# Autodesk Inventor assembly: MM0948AN180_G11_001
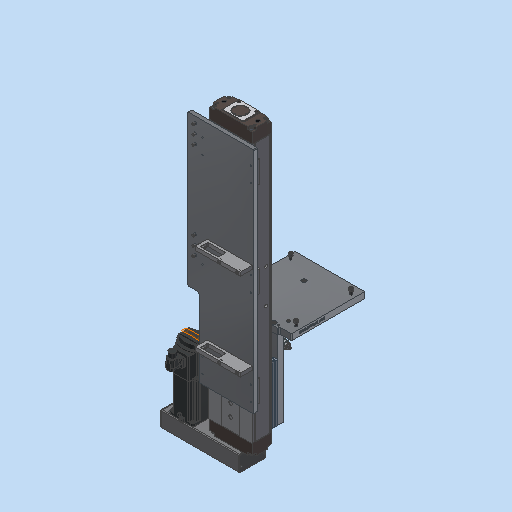
[picture p0: Inventor's stored thumbnail of the model, 512x512]
Saved by Autodesk Inventor 2023.3 (Build 273359000, 359)
## iProperties
Part Number: MM0948AN180_G11_001
Material: Generisch
Description: =<RBPARTNOTITLE2>
Document SubType Name: Assembly
Designer: FH/Wi
Mass: 75638.9 g
Surface Area: 20071.3 cm^2
Volume: 12011.2 cm^3
Density: 6.29734 g/cm^3
Created: 2023-03-23
RBPARTMADEOF: --
RBDRAWINGMISSINGSPEC: --
AnP_Kategorie: 99
RBPARTNOTITLE2: Magazinachse CIPG
RBSURFACE: --
RBPARTNOTITLE1: depot axis CIPG
AnP_Material: =<Material>
RBMATERIAL: =<Material>
RBMATNO: =<Part Number>
RBPARTNO: SIEHE MNR
Author: FH/Wi
Keywords: =<RBPARTMADEOF>
Comments: =<RBSURFACE2>
Revision Number: 01
## Documents named in this file (27)
- C:\Users\rea9an\Documents\Inventor\TCAI2412_te1910_EM\AS00000970.iam
- C:\Users\rea9an\Documents\Inventor\TCAI2412_te1910_EM\PT00004895.ipt
- C:\Users\rea9an\Documents\Inventor\TCAI2412_te1910_EM\PT00004901.ipt
- C:\Users\rea9an\Documents\Inventor\TCAI2412_te1910_EM\AS00000904.iam
- C:\Users\rea9an\Documents\Inventor\TCAI2412_te1910_EM\PT00004791.ipt
- C:\Users\rea9an\Documents\Inventor\TCAI2412_te1910_EM\PT00004523.ipt
- C:\Users\rea9an\Documents\Inventor\TCAI2412_te1910_EM\PT00004887.ipt
- C:\Users\rea9an\Documents\Inventor\TCAI2412_te1910_EM\PT00004891.ipt
- C:\Users\rea9an\Documents\Inventor\TCAI2412_te1910_EM\PT00004519.ipt
- C:\Users\rea9an\Documents\Inventor\TCAI2412_te1910_EM\PT00004518.ipt
- C:\Users\rea9an\Documents\Inventor\TCAI2412_te1910_EM\PT00004517.ipt
- C:\Users\rea9an\Documents\Inventor\TCAI2412_te1910_EM\PT00004520.ipt
- C:\Users\rea9an\Documents\Inventor\TCAI2412_te1910_EM\PT00004521.ipt
- C:\Users\rea9an\Documents\Inventor\TCAI2412_te1910_EM\PT00004292.ipt
- C:\Users\rea9an\Documents\Inventor\TCAI2412_te1910_EM\PT00004888.ipt
- C:\Users\rea9an\Documents\Inventor\TCAI2412_te1910_EM\PT00004886.ipt
- C:\Users\rea9an\Documents\Inventor\TCAI2412_te1910_EM\PT00004903.ipt
- C:\Users\rea9an\Documents\Inventor\TCAI2412_te1910_EM\PT00004896.ipt
- C:\Users\rea9an\Documents\Inventor\TCAI2412_te1910_EM\PT00004902.ipt
- C:\Users\rea9an\Documents\Inventor\TCAI2412_te1910_EM\PT00004711.ipt
- C:\Users\rea9an\Documents\Inventor\TCAI2412_te1910_EM\PT00004712.ipt
- C:\Users\rea9an\Documents\Inventor\TCAI2412_te1910_EM\PT00004713.ipt
- C:\Users\rea9an\Documents\Inventor\TCAI2412_te1910_EM\PT00004714.ipt
- C:\Users\rea9an\Documents\Inventor\TCAI2412_te1910_EM\PT00004897.ipt
- C:\Users\rea9an\Documents\Inventor\TCAI2412_te1910_EM\PT00004909.ipt
- C:\Users\rea9an\Documents\Inventor\TCAI2412_te1910_EM\PT00004877.ipt
- C:\Users\rea9an\Documents\Inventor\TCAI2412_te1910_EM\PT00004715.ipt
## Components (75 placed, 26 different names)
1. PT00004711:1 — Einfügen:3, Einfügen:5
2. PT00004715:1 — Einfügen:5, Passend:10, Einfügen:6, Einfügen:7, Einfügen:8, Einfügen:9, Einfügen:10, Einfügen:72, Einfügen:73, Einfügen:74, Einfügen:75, Einfügen:76, Einfügen:77, Einfügen:78, Einfügen:79
3. PT00004712:1 — Einfügen:3, Passend:10, Einfügen:34, Einfügen:36, Einfügen:37, Einfügen:38, Einfügen:39, Einfügen:40, Einfügen:41, Einfügen:42, Einfügen:43, Einfügen:44, Einfügen:45, Einfügen:46, Einfügen:67, Einfügen:68, Einfügen:69, Einfügen:70, Einfügen:71, Hub
4. PT00004713:1 — Passend:23, Passend:24, Passend:26, Passend:27, Passend:28, Passend:29, Passend:30, Einfügen:18, Einfügen:19, Passend:35, Passend:36, Fluchtend:24, Passend:37, Passend:39, Passend:40, Einfügen:59, Einfügen:60, Einfügen:61, Einfügen:62, Einfügen:63, Einfügen:64, Passend:50, Passend:51, Passend:52
5. PT00004714:1 — Passend:35, Einfügen:21, Passend:39, Passend:40, Einfügen:22, Einfügen:23
6. PT00004714:2 — Passend:36, Fluchtend:24, Einfügen:20, Passend:37, Einfügen:24, Einfügen:25
7. PT00004877:1 — Einfügen:78
8. PT00004877:2 — Einfügen:79
9. PT00004909:1 — Einfügen:76
10. PT00004909:2 — Einfügen:77
11. PT00004897:1 — Einfügen:73
12. PT00004897:2 — Einfügen:72
13. PT00004897:3 — Einfügen:75
14. PT00004897:4 — Einfügen:74
15. PT00004519:1
16. PT00004518:1 — Passend:53
17. PT00004517:1 — Einfügen:33
18. PT00004520:1
19. PT00004521:1 — Einfügen:34, Winkel:3, Passend:53
20. PT00004887:1 — Einfügen:20
21. PT00004887:2 — Einfügen:21
22. PT00004891:1 — Einfügen:25
23. PT00004891:2 — Einfügen:24
24. PT00004891:3 — Einfügen:23
25. PT00004891:4 — Einfügen:22
26. PT00004791:1 — Einfügen:66
27. PT00004791:2 — Einfügen:65
28. PT00004791:3 — Einfügen:19, Passend:48
29. PT00004791:4 — Einfügen:18, Passend:31
30. PT00004895:1 — Einfügen:6
31. PT00004895:2 — Einfügen:7
32. PT00004895:3 — Einfügen:8
33. PT00004901:1 — Einfügen:9
34. PT00004901:2 — Einfügen:10
35. AS00000904:1 [sub-assembly] — Passend:23, Passend:31, Einfügen:33, Winkel:3, Passend:48, Einfügen:65, Einfügen:66, Einfügen:67, Hub
36. PT00004888:1
37. PT00004292:1 — Einfügen:36
38. PT00004292:2 — Einfügen:37
39. PT00004292:3 — Einfügen:38
40. PT00004292:4 — Einfügen:41
41. PT00004292:5 — Einfügen:40
42. PT00004292:6 — Einfügen:39
43. PT00004888:2 — Einfügen:42
44. PT00004888:3 — Einfügen:43
45. PT00004888:4 — Einfügen:44
46. PT00004888:5 — Einfügen:45
47. PT00004888:6 — Einfügen:46
48. PT00004886:1 — Einfügen:48
49. PT00004886:2 — Einfügen:47
50. PT00004886:3 — Einfügen:49
51. PT00004886:4 — Einfügen:50
52. PT00004886:5 — Einfügen:51
53. PT00004886:6 — Einfügen:52
54. PT00004886:7 — Einfügen:53
55. PT00004886:8 — Einfügen:54
56. PT00004886:9 — Einfügen:55
57. PT00004886:10 — Einfügen:56
58. PT00004886:11 — Einfügen:57
59. PT00004886:12 — Einfügen:58
60. PT00004895:4 — Einfügen:59
61. PT00004895:5 — Einfügen:60
62. PT00004895:6 — Einfügen:61
63. PT00004895:7 — Einfügen:62
64. PT00004903:1 — Einfügen:63
65. PT00004903:2 — Einfügen:64
66. PT00004896:1 — Einfügen:71
67. PT00004902:1 — Einfügen:68
68. PT00004896:2 — Einfügen:70
69. PT00004902:2 — Einfügen:69
70. PT00004523:2 — Passend:26, Passend:27, Passend:28, Einfügen:51, Einfügen:52
71. PT00004523:1 — Passend:24, Passend:29, Passend:30, Einfügen:53, Einfügen:54
72. PT00004523:3 — Einfügen:49, Einfügen:50
73. PT00004523:4 — Einfügen:55, Einfügen:56
74. PT00004523:5 — Einfügen:47, Einfügen:48
75. PT00004523:6 — Einfügen:57, Einfügen:58
## Component patterns: (3 elements, first: PT00004523:2 + PT00004523:1)
## Relationships (91: Insert 63, Mate 24, Flush 2, Angle 2)
- Einfügen:3 [Insert]: PT00004711:1 ↔ PT00004712:1
- Einfügen:5 [Insert]: PT00004711:1 ↔ PT00004715:1
- Passend:10 [Mate]: PT00004715:1 ↔ PT00004712:1
- Einfügen:6 [Insert]: PT00004715:1 ↔ PT00004895:1
- Einfügen:7 [Insert]: PT00004715:1 ↔ PT00004895:2
- Einfügen:8 [Insert]: PT00004715:1 ↔ PT00004895:3
- Einfügen:9 [Insert]: PT00004715:1 ↔ PT00004901:1
- Einfügen:10 [Insert]: PT00004715:1 ↔ PT00004901:2
- Passend:23 [Mate]: PT00004713:1 ↔ AS00000904:1
- Passend:24 [Mate]: PT00004713:1 ↔ PT00004523:1
- Passend:26 [Mate]: PT00004713:1 ↔ PT00004523:2
- Passend:27 [Mate]: PT00004713:1 ↔ PT00004523:2
- Passend:28 [Mate]: PT00004713:1 ↔ PT00004523:2
- Passend:29 [Mate]: PT00004713:1 ↔ PT00004523:1
- Passend:30 [Mate]: PT00004713:1 ↔ PT00004523:1
- Einfügen:18 [Insert]: PT00004713:1 ↔ PT00004791:4
- Einfügen:19 [Insert]: PT00004713:1 ↔ PT00004791:3
- Passend:31 [Mate]: PT00004791:4 ↔ AS00000904:1
- Passend:35 [Mate]: PT00004713:1 ↔ PT00004714:1
- Passend:36 [Mate]: PT00004713:1 ↔ PT00004714:2
- Fluchtend:24 [Flush] (65 mm): PT00004713:1 ↔ PT00004714:2
- Einfügen:20 [Insert]: PT00004714:2 ↔ PT00004887:1
- Einfügen:21 [Insert]: PT00004714:1 ↔ PT00004887:2
- Passend:37 [Mate]: PT00004713:1 ↔ PT00004714:2
- Passend:39 [Mate]: PT00004713:1 ↔ PT00004714:1
- Passend:40 [Mate]: PT00004713:1 ↔ PT00004714:1
- Einfügen:22 [Insert]: PT00004714:1 ↔ PT00004891:4
- Einfügen:23 [Insert]: PT00004714:1 ↔ PT00004891:3
- Einfügen:24 [Insert]: PT00004714:2 ↔ PT00004891:2
- Einfügen:25 [Insert]: PT00004714:2 ↔ PT00004891:1
- [Insert]: PT00004519:1 ↔ PT00004518:1
- [Angle] (0 deg): PT00004519:1 ↔ PT00004518:1
- [Mate]: PT00004519:1 ↔ PT00004517:1
- [Mate]: PT00004517:1 ↔ PT00004520:1
- [Mate] (-14.5 mm): PT00004517:1 ↔ PT00004520:1
- [Mate]: PT00004519:1 ↔ PT00004520:1
- [Mate] (-33 mm): PT00004519:1 ↔ PT00004520:1
- Einfügen:33 [Insert] (-3.5 mm): PT00004517:1 ↔ AS00000904:1
- Einfügen:34 [Insert]: PT00004712:1 ↔ PT00004521:1
- Winkel:3 [Angle] (90 deg): PT00004521:1 ↔ AS00000904:1
- [Insert]: PT00004712:1 ↔ PT00004888:1
- Einfügen:36 [Insert] (1.5 mm): PT00004712:1 ↔ PT00004292:1
- Einfügen:37 [Insert] (1.5 mm): PT00004712:1 ↔ PT00004292:2
- Einfügen:38 [Insert] (1.5 mm): PT00004712:1 ↔ PT00004292:3
- Einfügen:39 [Insert] (1.5 mm): PT00004712:1 ↔ PT00004292:6
- Einfügen:40 [Insert] (1.5 mm): PT00004712:1 ↔ PT00004292:5
- Einfügen:41 [Insert] (1.5 mm): PT00004712:1 ↔ PT00004292:4
- Einfügen:42 [Insert]: PT00004712:1 ↔ PT00004888:2
- Einfügen:43 [Insert]: PT00004712:1 ↔ PT00004888:3
- Einfügen:44 [Insert]: PT00004712:1 ↔ PT00004888:4
- Einfügen:45 [Insert]: PT00004712:1 ↔ PT00004888:5
- Einfügen:46 [Insert]: PT00004712:1 ↔ PT00004888:6
- Einfügen:47 [Insert]: PT00004886:2 ↔ PT00004523:5
- Einfügen:48 [Insert]: PT00004886:1 ↔ PT00004523:5
- Einfügen:49 [Insert]: PT00004886:3 ↔ PT00004523:3
- Einfügen:50 [Insert]: PT00004886:4 ↔ PT00004523:3
- Einfügen:51 [Insert]: PT00004886:5 ↔ PT00004523:2
- Einfügen:52 [Insert]: PT00004886:6 ↔ PT00004523:2
- Einfügen:53 [Insert]: PT00004886:7 ↔ PT00004523:1
- Einfügen:54 [Insert]: PT00004886:8 ↔ PT00004523:1
- Einfügen:55 [Insert]: PT00004886:9 ↔ PT00004523:4
- Einfügen:56 [Insert]: PT00004886:10 ↔ PT00004523:4
- Einfügen:57 [Insert]: PT00004886:11 ↔ PT00004523:6
- Einfügen:58 [Insert]: PT00004886:12 ↔ PT00004523:6
- Passend:48 [Mate]: PT00004791:3 ↔ AS00000904:1
- Einfügen:59 [Insert]: PT00004713:1 ↔ PT00004895:4
- Einfügen:60 [Insert]: PT00004713:1 ↔ PT00004895:5
- Einfügen:61 [Insert]: PT00004713:1 ↔ PT00004895:6
- Einfügen:62 [Insert]: PT00004713:1 ↔ PT00004895:7
- Einfügen:63 [Insert]: PT00004713:1 ↔ PT00004903:1
- Einfügen:64 [Insert]: PT00004713:1 ↔ PT00004903:2
- Einfügen:65 [Insert]: PT00004791:2 ↔ AS00000904:1
- Einfügen:66 [Insert]: PT00004791:1 ↔ AS00000904:1
- Einfügen:67 [Insert]: PT00004712:1 ↔ AS00000904:1
- Einfügen:68 [Insert]: PT00004712:1 ↔ PT00004902:1
- Einfügen:69 [Insert]: PT00004712:1 ↔ PT00004902:2
- Einfügen:70 [Insert]: PT00004712:1 ↔ PT00004896:2
- Einfügen:71 [Insert]: PT00004712:1 ↔ PT00004896:1
- Passend:50 [Mate] (-1078 mm): PT00004713:1
- Passend:51 [Mate] (-330 mm): PT00004713:1
- Passend:52 [Mate] (1495 mm): PT00004713:1
- Passend:53 [Mate]: PT00004518:1 ↔ PT00004521:1
- Hub [Flush] (-52.5 mm): PT00004712:1 ↔ AS00000904:1
- Einfügen:72 [Insert] (11 mm): PT00004715:1 ↔ PT00004897:2
- Einfügen:73 [Insert] (11 mm): PT00004715:1 ↔ PT00004897:1
- Einfügen:74 [Insert] (11 mm): PT00004715:1 ↔ PT00004897:4
- Einfügen:75 [Insert] (11 mm): PT00004715:1 ↔ PT00004897:3
- Einfügen:76 [Insert]: PT00004715:1 ↔ PT00004909:1
- Einfügen:77 [Insert]: PT00004715:1 ↔ PT00004909:2
- Einfügen:78 [Insert]: PT00004715:1 ↔ PT00004877:1
- Einfügen:79 [Insert]: PT00004715:1 ↔ PT00004877:2
## Named parameters: d115_d86 = 0 deg, d116_d92 = 0 mm, d117_d93 = 0 mm, d118_d94 = -14.5 mm, d119_d95 = 0 mm, d120_d96 = -33 mm
